# Autodesk Inventor assembly: asm_moteur
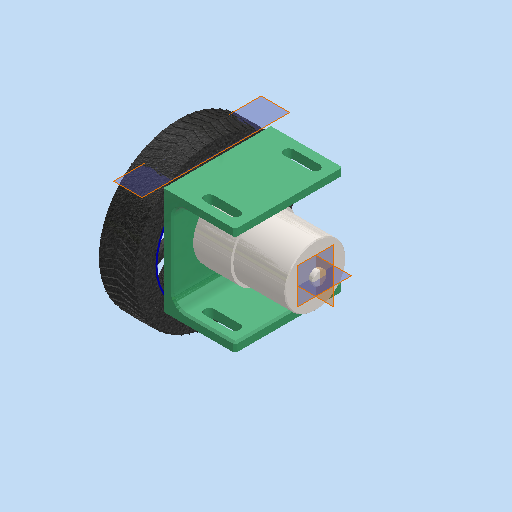
[picture p0: Inventor's stored thumbnail of the model, 512x512]
Saved by Autodesk Inventor 2026 (Build 300175050, 175E)
## iProperties
Created: 2025-05-15
Part Number: asm_moteur
Document SubType Name: Assembly
Designer: remg9
Author: remg9
## Documents named in this file (5)
- C:\Users\karle\OneDrive - HESSO\P2511_Dossier_partage_RVEZ\01_Robot\0101_CAO\Moteur\asm_moteur.iam
- C:\Users\karle\OneDrive - HESSO\P2511_Dossier_partage_RVEZ\01_Robot\0101_CAO\Moteur\Support moteur double.ipt
- C:\Users\karle\OneDrive - HESSO\P2511_Dossier_partage_RVEZ\01_Robot\0101_CAO\Moteur\modelcraftrb3500300001\modelcraftrb3500300001\modelcraftrb3500300001.ipt
- C:\Users\karle\OneDrive - HESSO\P2511_Dossier_partage_RVEZ\01_Robot\0101_CAO\Moteur\roues_3d_moteur.ipt
- C:\Users\karle\OneDrive - HESSO\P2511_Dossier_partage_RVEZ\01_Robot\0101_CAO\Moteur\roues_3d_moteur_tpu.ipt
## Components (4 placed, 4 different names)
1. Support moteur double:1 — Einfügen:4, Einfügen:5
2. modelcraftrb3500300001:1 — Einfügen:4, Einfügen:5, Passend:1, Einfügen:8
3. roues_3d_moteur:1 — Passend:1, Einfügen:8, Passend:2, Fluchtend:1
4. roues_3d_moteur_tpu:1 — Passend:2, Fluchtend:1
## Relationships (6: Insert 3, Mate 2, Flush 1)
- Einfügen:4 [Insert]: Support moteur double:1 ↔ modelcraftrb3500300001:1
- Einfügen:5 [Insert]: Support moteur double:1 ↔ modelcraftrb3500300001:1
- Passend:1 [Mate]: modelcraftrb3500300001:1 ↔ roues_3d_moteur:1
- Einfügen:8 [Insert]: modelcraftrb3500300001:1 ↔ roues_3d_moteur:1
- Passend:2 [Mate]: roues_3d_moteur:1 ↔ roues_3d_moteur_tpu:1
- Fluchtend:1 [Flush]: roues_3d_moteur:1 ↔ roues_3d_moteur_tpu:1
